# Autodesk Inventor assembly: Sandläufer_BG_1
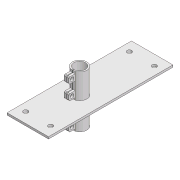
[picture p0: Inventor's stored thumbnail of the model, 180x180]
Saved by Autodesk Inventor 2020.1 (Build 241239000, 239)
## iProperties
Created: 2020-09-23
Part Number: Sandläufer_BG_1
Document SubType Name: Assembly
Designer: s5chfeis
Author: s5chfeis
## Documents named in this file (3)
- Z:\Masterarbeit\CAD\CAD\Sandläufer_BG_1.iam
- Z:\Masterarbeit\CAD\CAD\Rotorschutz_SL_BT2.ipt
- Z:\Masterarbeit\CAD\CAD\Huelse_2_komplett.iam
## Components (3 placed, 2 different names)
1. Rotorschutz_SL_BT2:1 — Passend:1, Passend:2, Passend:3, Passend:4
2. Huelse_2_komplett:1 [sub-assembly] — Passend:1, Passend:2
3. Huelse_2_komplett:2 [sub-assembly] — Passend:3, Passend:4
## Relationships (4: Mate 4)
- Passend:1 [Mate]: Rotorschutz_SL_BT2:1 ↔ Huelse_2_komplett:1
- Passend:2 [Mate]: Rotorschutz_SL_BT2:1 ↔ Huelse_2_komplett:1
- Passend:3 [Mate]: Rotorschutz_SL_BT2:1 ↔ Huelse_2_komplett:2
- Passend:4 [Mate]: Rotorschutz_SL_BT2:1 ↔ Huelse_2_komplett:2
